# Autodesk Inventor assembly: PneumaticGripper_v1.1
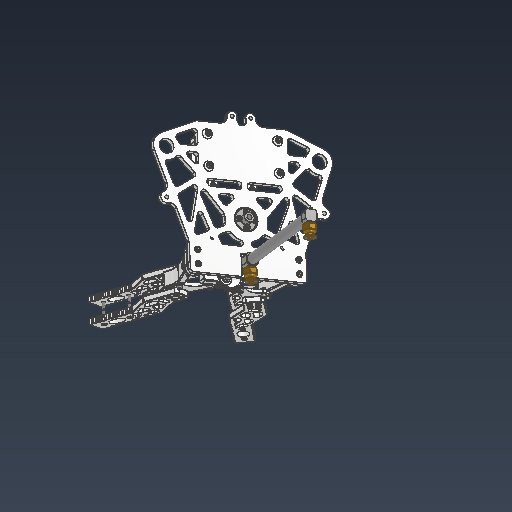
[picture p0: Inventor's stored thumbnail of the model, 512x512]
Saved by Autodesk Inventor 2026.2 (Build 302298010, 298A)
## iProperties
Created: 2026-05-08
Part Number: PneumaticGripper_v1.1
Document SubType Name: Assembly
Designer: work
Mass: 348.175 g
Surface Area: 1000.09 cm^2
Volume: 158.822 cm^3
Density: 2.19223 g/cm^3
Author: work
## Documents named in this file (17)
- C:\Users\khw\Desktop\ARD_v1\ARD_hardware\PneumaticGripper_v1\PneumaticGripper_v1.1.iam
- C:\Users\khw\Desktop\ARD_v1\ARD_hardware\PneumaticGripper_v1\Pneumatic fitting\CDJ2B10_100\CDJ2B10.iam
- C:\Users\khw\Desktop\ARD_v1\ARD_hardware\PneumaticGripper_v1\Pneumatic fitting\CDJ2B10_100\Rod.ipt
- C:\Users\khw\Desktop\ARD_v1\ARD_hardware\PneumaticGripper_v1\Pneumatic fitting\CDJ2B10_100\AS 1474 - M4(1).ipt
- C:\Users\khw\Desktop\ARD_v1\ARD_hardware\PneumaticGripper_v1\Bottom Link Parts.ipt
- C:\Users\khw\Desktop\ARD_v1\ARD_hardware\PneumaticGripper_v1\Link Support Parts.ipt
- C:\Users\khw\Desktop\ARD_v1\ARD_hardware\PneumaticGripper_v1\Link Parts.ipt
- C:\Users\khw\Desktop\ARD_v1\ARD_hardware\SCARA_v1\Object\KS B 1003 - M 3 x 12.ipt
- C:\Users\khw\Desktop\ARD_v1\ARD_hardware\PneumaticGripper_v1\Object\JIS B 1181 - A_B M3.ipt
- C:\Users\khw\Desktop\ARD_v1\ARD_hardware\PneumaticGripper_v1\rod-fixing parts.ipt
- C:\Users\khw\Desktop\ARD_v1\ARD_hardware\PneumaticGripper_v1\TONGS SE\O-RING_R.ipt
- C:\Users\khw\Desktop\ARD_v1\ARD_hardware\PneumaticGripper_v1\TONGS SE\O-RING_L.ipt
- C:\Users\khw\Desktop\ARD_v1\ARD_hardware\PneumaticGripper_v1\Object\KS B 1003 - M 3 x 12.ipt
- C:\Users\khw\Desktop\ARD_v1\ARD_hardware\PneumaticGripper_v1\Cylinder-CAM fixing parts_v2.dwg.ipt
- C:\Users\khw\Desktop\ARD_v1\ARD_hardware\PneumaticGripper_v1\CS.ipt
- C:\Users\khw\Desktop\ARD_v1\ARD_hardware\PneumaticGripper_v1\Object\flange joint 16pi (5 to 3).ipt
- Cylinder-CAM fixing parts_v2.dwg
## Components (74 placed, 14 different names)
1. CDJ2B10:1 [sub-assembly] — 메이트:8, 메이트:69, 각도:8
2. Rod:1 — 메이트:4, 메이트:5, 플러쉬:1, 메이트:8, 메이트:60, 메이트:68
3. AS 1474 - M4(1):1 — 메이트:5, 플러쉬:1, 메이트:61
4. AS 1474 - M4(1):2 — 메이트:4, 메이트:67
5. Bottom Link Parts:1 — 삽입:33, 삽입:34, 각도:7, 플러쉬:3, 메이트:55, 메이트:56, 메이트:57, 플러쉬:5, 플러쉬:6, 메이트:63, 메이트:64, 삽입:92, 삽입:97, 메이트:74
6. Bottom Link Parts:2 — 메이트:22, 삽입:31, 삽입:48, 각도:7, 메이트:62, 플러쉬:6, 메이트:65, 메이트:66, 삽입:93, 삽입:94, 메이트:73
7. Link Support Parts:1 — 메이트:21, 메이트:71, 메이트:72, 삽입:98, 삽입:99
8. Link Support Parts:2 — 메이트:58, 플러쉬:4, 메이트:70, 메이트:75, 삽입:100, 삽입:101
9. Link Parts:1 — 메이트:21, 메이트:22, 플러쉬:8, 삽입:90, 삽입:95
10. rod-fixing parts:1 — 플러쉬:3, 메이트:60, 메이트:61, 메이트:62, 메이트:63, 메이트:67, 메이트:79
11. O-RING_R:1 — 메이트:47, 메이트:48, 삽입:66, 삽입:67, 삽입:86, 삽입:87, 삽입:88, 삽입:89, 메이트:73
12. O-RING_L:1 — 메이트:47, 메이트:48, 삽입:68, 삽입:69, 메이트:65, 메이트:66, 플러쉬:7, 삽입:74, 삽입:75, 삽입:76, 삽입:77, 플러쉬:9
13. KS B 1003 - M 3 x 12:30 — 삽입:66
14. KS B 1003 - M 3 x 12:31 — 삽입:67
15. KS B 1003 - M 3 x 12:32 — 삽입:68
16. KS B 1003 - M 3 x 12:33 — 삽입:69
17. O-RING_R:2 — 메이트:55, 메이트:56, 메이트:57, 플러쉬:7, 삽입:78, 삽입:79, 삽입:80, 삽입:81
18. O-RING_L:2 — 삽입:82, 삽입:83, 삽입:84, 삽입:85, 플러쉬:9, 메이트:74
19. KS B 1003 - M 3 x 12:34
20. KS B 1003 - M 3 x 12:35
21. KS B 1003 - M 3 x 12:36
22. KS B 1003 - M 3 x 12:37
23. Link Parts:2 — 메이트:58, 플러쉬:4, 플러쉬:5, 메이트:64, 플러쉬:8, 삽입:91, 삽입:96
24. KS B 1003 - M 3 x 12:38 — 삽입:74
25. KS B 1003 - M 3 x 12:39 — 삽입:75
26. KS B 1003 - M 3 x 12:40 — 삽입:76
27. KS B 1003 - M 3 x 12:41 — 삽입:77
28. KS B 1003 - M 3 x 12:42 — 삽입:78
29. KS B 1003 - M 3 x 12:43 — 삽입:79
30. KS B 1003 - M 3 x 12:44 — 삽입:80
31. KS B 1003 - M 3 x 12:45 — 삽입:81
32. KS B 1003 - M 3 x 12:46 — 삽입:82
33. KS B 1003 - M 3 x 12:47 — 삽입:83
34. KS B 1003 - M 3 x 12:48 — 삽입:84
35. KS B 1003 - M 3 x 12:49 — 삽입:85
36. KS B 1003 - M 3 x 12:50 — 삽입:86
37. KS B 1003 - M 3 x 12:51 — 삽입:87
38. KS B 1003 - M 3 x 12:52 — 삽입:88
39. KS B 1003 - M 3 x 12:53 — 삽입:89
40. KS B 1003 - M 3 x 12:54 — 삽입:90
41. KS B 1003 - M 3 x 12:55 — 삽입:91
42. KS B 1003 - M 3 x 12:56 — 삽입:92
43. KS B 1003 - M 3 x 12:57 — 삽입:93
44. KS B 1003 - M 3 x 12:58 — 삽입:94
45. KS B 1003 - M 3 x 12:59 — 삽입:95
46. KS B 1003 - M 3 x 12:60 — 삽입:96
47. KS B 1003 - M 3 x 12:61 — 삽입:97
48. Cylinder-CAM fixing parts_v2.dwg:1 — 메이트:68, 메이트:69, 메이트:70, 메이트:71, 메이트:72, 메이트:75, 메이트:76, 메이트:77, 메이트:78, 메이트:79, 메이트:80, 메이트:81, 메이트:82, 삽입:106, 삽입:107, 삽입:108, 삽입:109, 삽입:110, 삽입:111, 삽입:112, 삽입:113, 삽입:114, 삽입:115, 삽입:116, 삽입:117, 각도:8
49. CS:1 — 메이트:76, 메이트:77, 메이트:78
50. flange joint 16pi (5 to 3):1 — 메이트:80, 메이트:81, 메이트:82, 삽입:102, 삽입:103, 삽입:104, 삽입:105
51. KS B 1003 - M 3 x 12:62 — 삽입:98
52. KS B 1003 - M 3 x 12:63 — 삽입:99
53. KS B 1003 - M 3 x 12:64 — 삽입:100
54. KS B 1003 - M 3 x 12:65 — 삽입:101
55. KS B 1003 - M 3 x 12:66 — 삽입:102
56. KS B 1003 - M 3 x 12:67 — 삽입:103
57. KS B 1003 - M 3 x 12:68 — 삽입:104
58. KS B 1003 - M 3 x 12:69 — 삽입:105
59. KS B 1003 - M 3 x 12:70 — 삽입:106
60. KS B 1003 - M 3 x 12:71 — 삽입:107
61. KS B 1003 - M 3 x 12:72 — 삽입:108
62. KS B 1003 - M 3 x 12:73 — 삽입:109
63. JIS B 1181 - A_B M3:18 — 삽입:110
64. JIS B 1181 - A_B M3:19 — 삽입:111
65. JIS B 1181 - A_B M3:20 — 삽입:112
66. JIS B 1181 - A_B M3:21 — 삽입:113
67. JIS B 1181 - A_B M3:22 — 삽입:114
68. JIS B 1181 - A_B M3:23 — 삽입:115
69. JIS B 1181 - A_B M3:24 — 삽입:116
70. JIS B 1181 - A_B M3:25 — 삽입:117
71. JIS B 1181 - A_B M3:1 — 삽입:31
72. JIS B 1181 - A_B M3:2 — 삽입:33
73. JIS B 1181 - A_B M3:3 — 삽입:34
74. JIS B 1181 - A_B M3:17 — 삽입:48
## Relationships (102: Insert 56, Mate 36, Flush 8, Angle 2)
- 메이트:4 [Mate]: Rod:1 ↔ AS 1474 - M4(1):2
- 메이트:5 [Mate]: Rod:1 ↔ AS 1474 - M4(1):1
- 플러쉬:1 [Flush] (5 mm): Rod:1 ↔ AS 1474 - M4(1):1
- 메이트:8 [Mate]: CDJ2B10:1 ↔ Rod:1
- 메이트:21 [Mate]: Link Support Parts:1 ↔ Link Parts:1
- 메이트:22 [Mate]: Bottom Link Parts:2 ↔ Link Parts:1
- 삽입:31 [Insert]: Bottom Link Parts:2 ↔ JIS B 1181 - A_B M3:1
- 삽입:33 [Insert]: Bottom Link Parts:1 ↔ JIS B 1181 - A_B M3:2
- 삽입:34 [Insert]: Bottom Link Parts:1 ↔ JIS B 1181 - A_B M3:3
- 삽입:48 [Insert]: Bottom Link Parts:2 ↔ JIS B 1181 - A_B M3:17
- 각도:7 [Angle] (0 deg): Bottom Link Parts:1 ↔ Bottom Link Parts:2
- 메이트:47 [Mate]: O-RING_R:1 ↔ O-RING_L:1
- 메이트:48 [Mate]: O-RING_R:1 ↔ O-RING_L:1
- 삽입:66 [Insert]: O-RING_R:1 ↔ KS B 1003 - M 3 x 12:30
- 삽입:67 [Insert]: O-RING_R:1 ↔ KS B 1003 - M 3 x 12:31
- 삽입:68 [Insert]: O-RING_L:1 ↔ KS B 1003 - M 3 x 12:32
- 삽입:69 [Insert]: O-RING_L:1 ↔ KS B 1003 - M 3 x 12:33
- 플러쉬:3 [Flush]: Bottom Link Parts:1 ↔ rod-fixing parts:1
- [Mate]: O-RING_R:2 ↔ O-RING_L:2
- [Mate]: O-RING_R:2 ↔ O-RING_L:2
- [Insert]: O-RING_R:2 ↔ KS B 1003 - M 3 x 12:34
- [Insert]: O-RING_R:2 ↔ KS B 1003 - M 3 x 12:35
- [Insert]: O-RING_L:2 ↔ KS B 1003 - M 3 x 12:36
- [Insert]: O-RING_L:2 ↔ KS B 1003 - M 3 x 12:37
- 메이트:55 [Mate]: Bottom Link Parts:1 ↔ O-RING_R:2
- 메이트:56 [Mate]: Bottom Link Parts:1 ↔ O-RING_R:2
- 메이트:57 [Mate]: Bottom Link Parts:1 ↔ O-RING_R:2
- 메이트:58 [Mate]: Link Support Parts:2 ↔ Link Parts:2
- 플러쉬:4 [Flush]: Link Support Parts:2 ↔ Link Parts:2
- 플러쉬:5 [Flush]: Bottom Link Parts:1 ↔ Link Parts:2
- 메이트:60 [Mate]: Rod:1 ↔ rod-fixing parts:1
- 메이트:61 [Mate]: AS 1474 - M4(1):1 ↔ rod-fixing parts:1
- 메이트:62 [Mate]: Bottom Link Parts:2 ↔ rod-fixing parts:1
- 플러쉬:6 [Flush]: Bottom Link Parts:1 ↔ Bottom Link Parts:2
- 메이트:63 [Mate]: Bottom Link Parts:1 ↔ rod-fixing parts:1
- 메이트:64 [Mate]: Bottom Link Parts:1 ↔ Link Parts:2
- 메이트:65 [Mate]: Bottom Link Parts:2 ↔ O-RING_L:1
- 메이트:66 [Mate]: Bottom Link Parts:2 ↔ O-RING_L:1
- 플러쉬:7 [Flush]: O-RING_L:1 ↔ O-RING_R:2
- 플러쉬:8 [Flush]: Link Parts:1 ↔ Link Parts:2
- 메이트:67 [Mate]: AS 1474 - M4(1):2 ↔ rod-fixing parts:1
- 삽입:74 [Insert]: O-RING_L:1 ↔ KS B 1003 - M 3 x 12:38
- 삽입:75 [Insert]: O-RING_L:1 ↔ KS B 1003 - M 3 x 12:39
- 삽입:76 [Insert]: O-RING_L:1 ↔ KS B 1003 - M 3 x 12:40
- 삽입:77 [Insert]: O-RING_L:1 ↔ KS B 1003 - M 3 x 12:41
- 삽입:78 [Insert]: O-RING_R:2 ↔ KS B 1003 - M 3 x 12:42
- 삽입:79 [Insert]: O-RING_R:2 ↔ KS B 1003 - M 3 x 12:43
- 삽입:80 [Insert]: O-RING_R:2 ↔ KS B 1003 - M 3 x 12:44
- 삽입:81 [Insert]: O-RING_R:2 ↔ KS B 1003 - M 3 x 12:45
- 삽입:82 [Insert]: O-RING_L:2 ↔ KS B 1003 - M 3 x 12:46
- 삽입:83 [Insert]: O-RING_L:2 ↔ KS B 1003 - M 3 x 12:47
- 삽입:84 [Insert]: O-RING_L:2 ↔ KS B 1003 - M 3 x 12:48
- 삽입:85 [Insert]: O-RING_L:2 ↔ KS B 1003 - M 3 x 12:49
- 삽입:86 [Insert]: O-RING_R:1 ↔ KS B 1003 - M 3 x 12:50
- 삽입:87 [Insert]: O-RING_R:1 ↔ KS B 1003 - M 3 x 12:51
- 삽입:88 [Insert]: O-RING_R:1 ↔ KS B 1003 - M 3 x 12:52
- 삽입:89 [Insert]: O-RING_R:1 ↔ KS B 1003 - M 3 x 12:53
- 삽입:90 [Insert]: Link Parts:1 ↔ KS B 1003 - M 3 x 12:54
- 삽입:91 [Insert]: Link Parts:2 ↔ KS B 1003 - M 3 x 12:55
- 삽입:92 [Insert]: Bottom Link Parts:1 ↔ KS B 1003 - M 3 x 12:56
- 삽입:93 [Insert]: Bottom Link Parts:2 ↔ KS B 1003 - M 3 x 12:57
- 삽입:94 [Insert]: Bottom Link Parts:2 ↔ KS B 1003 - M 3 x 12:58
- 삽입:95 [Insert]: Link Parts:1 ↔ KS B 1003 - M 3 x 12:59
- 삽입:96 [Insert]: Link Parts:2 ↔ KS B 1003 - M 3 x 12:60
- 삽입:97 [Insert]: Bottom Link Parts:1 ↔ KS B 1003 - M 3 x 12:61
- 플러쉬:9 [Flush]: O-RING_L:1 ↔ O-RING_L:2
- 메이트:68 [Mate]: Rod:1 ↔ Cylinder-CAM fixing parts_v2.dwg:1
- 메이트:69 [Mate]: CDJ2B10:1 ↔ Cylinder-CAM fixing parts_v2.dwg:1
- 메이트:70 [Mate]: Link Support Parts:2 ↔ Cylinder-CAM fixing parts_v2.dwg:1
- 메이트:71 [Mate]: Link Support Parts:1 ↔ Cylinder-CAM fixing parts_v2.dwg:1
- 메이트:72 [Mate]: Link Support Parts:1 ↔ Cylinder-CAM fixing parts_v2.dwg:1
- 메이트:73 [Mate]: Bottom Link Parts:2 ↔ O-RING_R:1
- 메이트:74 [Mate]: Bottom Link Parts:1 ↔ O-RING_L:2
- 메이트:75 [Mate]: Link Support Parts:2 ↔ Cylinder-CAM fixing parts_v2.dwg:1
- 메이트:76 [Mate]: Cylinder-CAM fixing parts_v2.dwg:1 ↔ CS:1
- 메이트:77 [Mate]: Cylinder-CAM fixing parts_v2.dwg:1 ↔ CS:1
- 메이트:78 [Mate]: Cylinder-CAM fixing parts_v2.dwg:1 ↔ CS:1
- 메이트:79 [Mate]: rod-fixing parts:1 ↔ Cylinder-CAM fixing parts_v2.dwg:1
- 메이트:80 [Mate]: Cylinder-CAM fixing parts_v2.dwg:1 ↔ flange joint 16pi (5 to 3):1
- 메이트:81 [Mate]: Cylinder-CAM fixing parts_v2.dwg:1 ↔ flange joint 16pi (5 to 3):1
- 메이트:82 [Mate]: Cylinder-CAM fixing parts_v2.dwg:1 ↔ flange joint 16pi (5 to 3):1
- 삽입:98 [Insert]: Link Support Parts:1 ↔ KS B 1003 - M 3 x 12:62
- 삽입:99 [Insert]: Link Support Parts:1 ↔ KS B 1003 - M 3 x 12:63
- 삽입:100 [Insert]: Link Support Parts:2 ↔ KS B 1003 - M 3 x 12:64
- 삽입:101 [Insert]: Link Support Parts:2 ↔ KS B 1003 - M 3 x 12:65
- 삽입:102 [Insert]: flange joint 16pi (5 to 3):1 ↔ KS B 1003 - M 3 x 12:66
- 삽입:103 [Insert]: flange joint 16pi (5 to 3):1 ↔ KS B 1003 - M 3 x 12:67
- 삽입:104 [Insert]: flange joint 16pi (5 to 3):1 ↔ KS B 1003 - M 3 x 12:68
- 삽입:105 [Insert]: flange joint 16pi (5 to 3):1 ↔ KS B 1003 - M 3 x 12:69
- 삽입:106 [Insert]: Cylinder-CAM fixing parts_v2.dwg:1 ↔ KS B 1003 - M 3 x 12:70
- 삽입:107 [Insert]: Cylinder-CAM fixing parts_v2.dwg:1 ↔ KS B 1003 - M 3 x 12:71
- 삽입:108 [Insert]: Cylinder-CAM fixing parts_v2.dwg:1 ↔ KS B 1003 - M 3 x 12:72
- 삽입:109 [Insert]: Cylinder-CAM fixing parts_v2.dwg:1 ↔ KS B 1003 - M 3 x 12:73
- 삽입:110 [Insert]: Cylinder-CAM fixing parts_v2.dwg:1 ↔ JIS B 1181 - A_B M3:18
- 삽입:111 [Insert]: Cylinder-CAM fixing parts_v2.dwg:1 ↔ JIS B 1181 - A_B M3:19
- 삽입:112 [Insert]: Cylinder-CAM fixing parts_v2.dwg:1 ↔ JIS B 1181 - A_B M3:20
- 삽입:113 [Insert]: Cylinder-CAM fixing parts_v2.dwg:1 ↔ JIS B 1181 - A_B M3:21
- 삽입:114 [Insert]: Cylinder-CAM fixing parts_v2.dwg:1 ↔ JIS B 1181 - A_B M3:22
- 삽입:115 [Insert]: Cylinder-CAM fixing parts_v2.dwg:1 ↔ JIS B 1181 - A_B M3:23
- 삽입:116 [Insert]: Cylinder-CAM fixing parts_v2.dwg:1 ↔ JIS B 1181 - A_B M3:24
- 삽입:117 [Insert]: Cylinder-CAM fixing parts_v2.dwg:1 ↔ JIS B 1181 - A_B M3:25
- 각도:8 [Angle] (180 deg): CDJ2B10:1 ↔ Cylinder-CAM fixing parts_v2.dwg:1
## Named parameters: d142_d132 = 0 mm, d143_d133 = 0 mm, d145_d135 = 0 mm, d146_d136 = 0 mm, d147_d137 = 0 mm, d148_d138 = 0 mm
